# Autodesk Inventor assembly: Camera_ASM
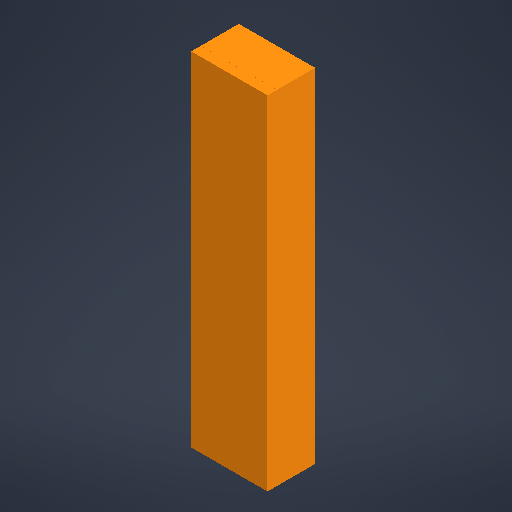
[picture p0: Inventor's stored thumbnail of the model, 512x512]
Saved by Autodesk Inventor 2026.2 (Build 302298010, 298A)
## iProperties
Created: 2026-10-11
Part Number: Camera_ASM
Document SubType Name: Assembly
Designer: User
Author: User
## Documents named in this file (4)
- D:\Autodesk Invento Pro Work\Honours Project\Parts\Camera_ASM.iam
- D:\Autodesk Invento Pro Work\Honours Project\Parts\Camera_mount_front.ipt
- D:\Autodesk Invento Pro Work\Honours Project\Parts\camera.ipt
- D:\Autodesk Invento Pro Work\Honours Project\Parts\Camera_mount_back.ipt
## Components (3 placed, 3 different names)
1. Camera_mount_front:1 — Mate:1, Rigid:1
2. camera:1 — Mate:1
3. Camera_mount_back:1 — Rigid:1
## Relationships (2: Mate 1, WeldJoint 1)
- Mate:1: Camera_mount_front:1 ↔ camera:1
- Rigid:1 [WeldJoint]: Camera_mount_front:1 ↔ Camera_mount_back:1
